# Autodesk Inventor assembly: MM0948AN140_G11_001
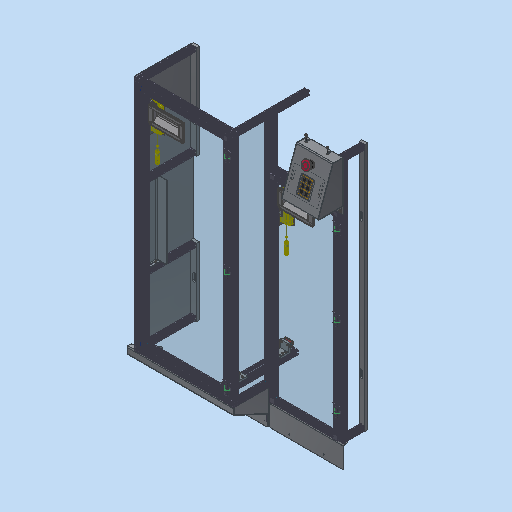
[picture p0: Inventor's stored thumbnail of the model, 512x512]
Saved by Autodesk Inventor 2023.3 (Build 273359000, 359)
## iProperties
Part Number: MM0948AN140_G11_001
Material: Generisch
Description: =<RBPARTNOTITLE2>
Document SubType Name: Assembly
Designer: FH/Wi
Mass: 13816.7 g
Surface Area: 52033.7 cm^2
Volume: 6143.07 cm^3
Density: 2.24915 g/cm^3
Created: 2023-03-23
RBCHANGEDESCRIPTION1: Erstfreigabe
RBCHANGENO1: 00
RBDOCUMENTTYPE: DRF
RBDOCUMENTVERSION: 00
RBDRAWINGMAINSCALE: 1:1
RBDRAWINGMISSINGSPEC: --
RBDRAWINGVOLUME: --
RBDSV1: 0850
RBGBDETAILS: 43274
RBGBEDGESIN1: +0,5
RBGBEDGESIN2: +0,2
RBGBEDGESOUT1: -0,3
RBGBEDGESOUT2: -0,1
RBMATERIAL: =<Material>
RBMATMEETS: --
RBMATNO: =<Part Number>
RBORGUNITRESPONSIBLE1: AnP/TEF1
RBPARTMADEOF: --
RBPARTNO: SIEHE MNR
RBPARTNOTITLE1: CIPG lower housing
RBPARTNOTITLE2: CIPG Schutz unten
RBPARTSAFETYINDICATOR: --
RBSURFACE: --
RBSURFACE2: --
RBZEDGESNORM: ISO13715:2002-06
RBZGENDIMCLASS: m
RBZGENDIMNORM: ISO 2768-1:1989-11
RBZGENGEOCLASS: H
RBZGENGEONORM: ISO 2768-2:1989-11
RBZSURFACENORM: ISO13D2:2002-02
RBZTOLERANCENORM: ISO 14405-1:2010-12
AnP_Kommentar: --
MaxAbmaße: --
AnP_TemplVers: 20190222
AnP_Kategorie: 99
AnP_Material: =<Material>
Author: FH/Wi
Keywords: =<RBPARTMADEOF>
Comments: =<RBSURFACE2>
Revision Number: 01
## Documents named in this file (26)
- C:\Users\rea9an\Documents\Inventor\TCAI2412_te1910_EM\AS00000958.iam
- C:\Users\rea9an\Documents\Inventor\TCAI2412_te1910_EM\PT00004318.ipt
- C:\Users\rea9an\Documents\Inventor\TCAI2412_te1910_EM\PT00004294.ipt
- C:\Users\rea9an\Documents\Inventor\TCAI2412_te1910_EM\PT00004673.ipt
- C:\Users\rea9an\Documents\Inventor\TCAI2412_te1910_EM\PT00004874.ipt
- C:\Users\rea9an\Documents\Inventor\TCAI2412_te1910_EM\PT00004674.ipt
- C:\Users\rea9an\Documents\Inventor\TCAI2412_te1910_EM\AS00000951.iam
- C:\Users\rea9an\Documents\Inventor\TCAI2412_te1910_EM\AS00000952.iam
- C:\Users\rea9an\Documents\Inventor\TCAI2412_te1910_EM\AS00000953.iam
- C:\Users\rea9an\Documents\Inventor\TCAI2412_te1910_EM\AS00000956.iam
- C:\Users\rea9an\Documents\Inventor\TCAI2412_te1910_EM\AS00000955.iam
- C:\Users\rea9an\Documents\Inventor\TCAI2412_te1910_EM\PT00004663.ipt
- C:\Users\rea9an\Documents\Inventor\TCAI2412_te1910_EM\PT00004323.ipt
- C:\Users\rea9an\Documents\Inventor\TCAI2412_te1910_EM\PT00004675.ipt
- C:\Users\rea9an\Documents\Inventor\TCAI2412_te1910_EM\PT00004922.ipt
- C:\Users\rea9an\Documents\Inventor\TCAI2412_te1910_EM\PT00004867.ipt
- C:\Users\rea9an\Documents\Inventor\TCAI2412_te1910_EM\AS00000954.iam
- C:\Users\rea9an\Documents\Inventor\TCAI2412_te1910_EM\PT00004348.ipt
- C:\Users\rea9an\Documents\Inventor\TCAI2412_te1910_EM\PT00004786.ipt
- C:\Users\rea9an\Documents\Inventor\TCAI2412_te1910_EM\PT00004680.ipt
- C:\Users\rea9an\Documents\Inventor\TCAI2412_te1910_EM\PT00004861.ipt
- C:\Users\rea9an\Documents\Inventor\TCAI2412_te1910_EM\PT00004782.ipt
- C:\Users\rea9an\Documents\Inventor\TCAI2412_te1910_EM\PT00004681.ipt
- C:\Users\rea9an\Documents\Inventor\TCAI2412_te1910_EM\PT00004388.ipt
- C:\Users\rea9an\Documents\Inventor\TCAI2412_te1910_EM\PT00004295.ipt
- C:\_AnPCAD\_AnP_CAD\MM\MM0948AN_DispensenStandardbaugruppen\MM0948AN140_Schutz\G10_Schutz_Ruestachse\MM0948AN140_G10_001.iam
## Components (52 placed, 24 different names)
1. PT00004663:1 — Passend:428, Fluchtend:292, Fluchtend:293
2. PT00004673:1 — Passend:364, Einfügen:62, Einfügen:63, Einfügen:64, Einfügen:65, Fluchtend:301
3. PT00004674:1 — Passend:434, Fluchtend:300
4. AS00000951:1 [sub-assembly] — Passend:412, Passend:420, Passend:421, Winkel:2
5. AS00000952:1 [sub-assembly] — Winkel:1, Passend:415, Passend:416, Passend:417, Fluchtend:286
6. AS00000953:1 [sub-assembly] — Fluchtend:283, Passend:435, Fluchtend:302
7. AS00000955:1 [sub-assembly] — Fluchtend:285, Passend:423, Fluchtend:286
8. AS00000956:1 [sub-assembly] — Fluchtend:273, Passend:422, Fluchtend:284
9. AS00000954:1 [sub-assembly] — Fluchtend:294, Fluchtend:295, Passend:364, Fluchtend:273, Passend:405, Fluchtend:278, Fluchtend:279, Winkel:1, Passend:412, Passend:415, Fluchtend:282, Winkel:2, Fluchtend:283, Passend:422, Fluchtend:284, Fluchtend:285, Passend:428, Fluchtend:292, Fluchtend:293, Fluchtend:296, Passend:423, Passend:432, Passend:434, Fluchtend:300, Fluchtend:301, Passend:435, Fluchtend:302, Passend:454, Fluchtend:308, Fluchtend:309
10. PT00004675:2 — Einfügen:79, Einfügen:80, Einfügen:81, Einfügen:82, Fluchtend:305, Fluchtend:307, Einfügen:91, Einfügen:92, Winkel:5
11. PT00004675:3 — Einfügen:77, Einfügen:78, Einfügen:83, Einfügen:84, Fluchtend:306, Fluchtend:307, Einfügen:85, Passend:450, Winkel:4
12. PT00004786:1 — Einfügen:85, Winkel:4, Einfügen:88, Passend:451
13. PT00004680:1 — Einfügen:88, Passend:451
14. PT00004782:1 — Einfügen:87, Passend:450
15. PT00004786:2 — Einfügen:91, Passend:453, Winkel:5, Einfügen:93, Einfügen:94
16. PT00004680:2 — Einfügen:92, Passend:453
17. PT00004861:3 — Einfügen:94
18. PT00004861:4 — Einfügen:93
19. PT00004681:1 — Passend:454, Fluchtend:308, Fluchtend:309, Einfügen:96
20. PT00004388:1 — Einfügen:95, Einfügen:96
21. PT00004295:1 — Einfügen:95
22. PT00004922:4 — Einfügen:77
23. PT00004922:3 — Einfügen:78
24. PT00004922:2 — Einfügen:79
25. PT00004922:1 — Einfügen:80
26. PT00004867:4
27. PT00004867:3
28. PT00004867:2
29. PT00004867:1
30. PT00004861:1 — Einfügen:87
31. PT00004861:2
32. PT00004874:1 — Einfügen:63
33. PT00004874:2 — Einfügen:64
34. PT00004874:3 — Einfügen:65
35. PT00004874:4 — Einfügen:62
36. PT00004294:5 — Einfügen:82
37. PT00004294:6 — Einfügen:84
38. PT00004294:7 — Einfügen:83
39. PT00004294:8 — Einfügen:81
40. PT00004323:1
41. PT00004323:2 — Passend:432
42. PT00004294:1
43. PT00004294:2
44. PT00004294:3
45. PT00004294:4
46. PT00004318:8 — Passend:408
47. PT00004318:9 — Passend:405, Fluchtend:278, Fluchtend:279, Passend:408
48. PT00004318:10 — Passend:416, Passend:417
49. PT00004318:5 — Passend:170, Fluchtend:266, Passend:395, Fluchtend:282
50. PT00004318:6 — Passend:169, Passend:170, Fluchtend:266
51. PT00004318:7 — Passend:169, Passend:395, Passend:420, Passend:421
52. PT00004348:1
## Relationships (98: Mate 34, Flush 30, Insert 30, Angle 4)
- Passend:169 [Mate] (380 mm): PT00004318:6 ↔ PT00004318:7
- Passend:170 [Mate] (380 mm): PT00004318:5 ↔ PT00004318:6
- Fluchtend:294 [Flush]: AS00000954:1
- Fluchtend:295 [Flush]: AS00000954:1
- [Mate]: AS00000954:1 ↔ PT00004318:5
- [Mate]: AS00000954:1 ↔ PT00004318:6
- [Flush]: PT00004318:10 ↔ PT00004318:7
- Passend:364 [Mate]: PT00004673:1 ↔ AS00000954:1
- [Mate]: PT00004673:1 ↔ AS00000954:1
- Einfügen:62 [Insert]: PT00004673:1 ↔ PT00004874:4
- Einfügen:63 [Insert]: PT00004673:1 ↔ PT00004874:1
- Einfügen:64 [Insert]: PT00004673:1 ↔ PT00004874:2
- Einfügen:65 [Insert]: PT00004673:1 ↔ PT00004874:3
- [Insert] (1 mm): PT00004673:1 ↔ PT00004294:1
- [Insert] (1 mm): PT00004673:1 ↔ PT00004294:2
- [Insert] (1 mm): PT00004673:1 ↔ PT00004294:4
- [Insert] (1 mm): PT00004673:1 ↔ PT00004294:3
- [Flush] (2.5 mm): AS00000954:1 ↔ PT00004318:5
- Fluchtend:266 [Flush]: PT00004318:5 ↔ PT00004318:6
- Passend:395 [Mate]: PT00004318:5 ↔ PT00004318:7
- [Mate] (1.5 mm): PT00004674:1 ↔ AS00000954:1
- Fluchtend:273 [Flush] (90 mm): AS00000956:1 ↔ AS00000954:1
- [Flush] (-334.5 mm): PT00004318:8 ↔ PT00004318:10
- Passend:405 [Mate]: AS00000954:1 ↔ PT00004318:9
- Fluchtend:278 [Flush] (2.5 mm): AS00000954:1 ↔ PT00004318:9
- Fluchtend:279 [Flush] (250 mm): AS00000954:1 ↔ PT00004318:9
- [Mate]: PT00004318:8 ↔ PT00004318:10
- Passend:408 [Mate]: PT00004318:8 ↔ PT00004318:9
- Winkel:1 [Angle] (0 deg): AS00000952:1 ↔ AS00000954:1
- Passend:412 [Mate] (5 mm): AS00000951:1 ↔ AS00000954:1
- Passend:415 [Mate] (5 mm): AS00000952:1 ↔ AS00000954:1
- Passend:416 [Mate]: AS00000952:1 ↔ PT00004318:10
- Passend:417 [Mate] (-2.5 mm): AS00000952:1 ↔ PT00004318:10
- Fluchtend:282 [Flush] (-70 mm): AS00000954:1 ↔ PT00004318:5
- Passend:420 [Mate]: AS00000951:1 ↔ PT00004318:7
- Passend:421 [Mate] (-2.5 mm): AS00000951:1 ↔ PT00004318:7
- Winkel:2 [Angle] (0 deg): AS00000951:1 ↔ AS00000954:1
- Fluchtend:283 [Flush]: AS00000953:1 ↔ AS00000954:1
- Passend:422 [Mate]: AS00000956:1 ↔ AS00000954:1
- Fluchtend:284 [Flush] (4 mm): AS00000956:1 ↔ AS00000954:1
- Fluchtend:285 [Flush] (4 mm): AS00000955:1 ↔ AS00000954:1
- Passend:423 [Mate]: AS00000955:1 ↔ AS00000954:1
- Fluchtend:286 [Flush] (-80 mm): AS00000952:1 ↔ AS00000955:1
- [Mate]: AS00000954:1 ↔ PT00004348:1
- [Flush]: AS00000954:1 ↔ PT00004348:1
- Passend:428 [Mate]: PT00004663:1 ↔ AS00000954:1
- Fluchtend:292 [Flush]: PT00004663:1 ↔ AS00000954:1
- Fluchtend:293 [Flush]: PT00004663:1 ↔ AS00000954:1
- Fluchtend:296 [Flush] (-45 mm): AS00000954:1
- [Mate]: PT00004323:2 ↔ PT00004348:1
- [Flush] (-1 mm): PT00004323:2 ↔ PT00004348:1
- Passend:432 [Mate]: AS00000954:1 ↔ PT00004323:2
- [Flush]: PT00004323:1 ↔ PT00004348:1
- [Flush] (1 mm): PT00004323:1 ↔ PT00004348:1
- [Mate]: PT00004323:1 ↔ PT00004348:1
- Passend:434 [Mate] (1.5 mm): PT00004674:1 ↔ AS00000954:1
- Fluchtend:300 [Flush] (7.5 mm): PT00004674:1 ↔ AS00000954:1
- Fluchtend:301 [Flush]: PT00004673:1 ↔ AS00000954:1
- Passend:435 [Mate]: AS00000953:1 ↔ AS00000954:1
- Fluchtend:302 [Flush]: AS00000953:1 ↔ AS00000954:1
- [Mate]: PT00004675:2 ↔ PT00004348:1
- [Flush] (3 mm): PT00004675:2 ↔ PT00004348:1
- [Mate] (-46.4 mm): PT00004348:1
- [Mate]: PT00004675:3 ↔ PT00004348:1
- [Insert]: PT00004675:3 ↔ PT00004861:2
- [Insert]: PT00004675:3 ↔ PT00004867:1
- [Insert]: PT00004675:3 ↔ PT00004867:2
- [Insert]: PT00004675:2 ↔ PT00004867:3
- [Insert]: PT00004675:2 ↔ PT00004867:4
- Einfügen:77 [Insert]: PT00004675:3 ↔ PT00004922:4
- Einfügen:78 [Insert]: PT00004675:3 ↔ PT00004922:3
- Einfügen:79 [Insert]: PT00004675:2 ↔ PT00004922:2
- Einfügen:80 [Insert]: PT00004675:2 ↔ PT00004922:1
- Einfügen:81 [Insert] (1 mm): PT00004675:2 ↔ PT00004294:8
- Einfügen:82 [Insert] (1 mm): PT00004675:2 ↔ PT00004294:5
- Einfügen:83 [Insert] (1 mm): PT00004675:3 ↔ PT00004294:7
- Einfügen:84 [Insert] (1 mm): PT00004675:3 ↔ PT00004294:6
- Fluchtend:305 [Flush] (1724 mm): PT00004675:2
- Fluchtend:306 [Flush] (1510 mm): PT00004675:3
- Fluchtend:307 [Flush]: PT00004675:2 ↔ PT00004675:3
- Einfügen:85 [Insert]: PT00004675:3 ↔ PT00004786:1
- [Mate]: PT00004786:1 ↔ PT00004861:1
- Einfügen:87 [Insert]: PT00004782:1 ↔ PT00004861:1
- Passend:450 [Mate]: PT00004675:3 ↔ PT00004782:1
- Winkel:4 [Angle] (0 deg): PT00004675:3 ↔ PT00004786:1
- Einfügen:88 [Insert]: PT00004786:1 ↔ PT00004680:1
- Passend:451 [Mate]: PT00004786:1 ↔ PT00004680:1
- Einfügen:91 [Insert]: PT00004675:2 ↔ PT00004786:2
- Einfügen:92 [Insert]: PT00004675:2 ↔ PT00004680:2
- Passend:453 [Mate]: PT00004786:2 ↔ PT00004680:2
- Winkel:5 [Angle] (0 deg): PT00004675:2 ↔ PT00004786:2
- Einfügen:93 [Insert]: PT00004786:2 ↔ PT00004861:4
- Einfügen:94 [Insert]: PT00004786:2 ↔ PT00004861:3
- Passend:454 [Mate]: AS00000954:1 ↔ PT00004681:1
- Fluchtend:308 [Flush]: AS00000954:1 ↔ PT00004681:1
- Fluchtend:309 [Flush]: AS00000954:1 ↔ PT00004681:1
- Einfügen:95 [Insert] (3.2 mm): PT00004388:1 ↔ PT00004295:1
- Einfügen:96 [Insert]: PT00004681:1 ↔ PT00004388:1
